# Autodesk Inventor assembly: Assembly1
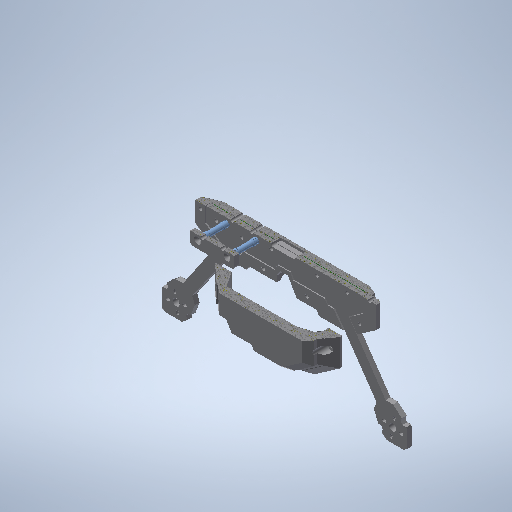
[picture p0: Inventor's stored thumbnail of the model, 512x512]
Saved by Autodesk Inventor 2025.2 (Build 292293000, 293)
## iProperties
Created: 2026-05-18
Part Number: Assembly1
Document SubType Name: Assembly
Designer: crazi
Author: crazi
## Documents named in this file (11)
- D:\Family\Arav\Projects\Drone\Chassis\Custom Chassis\Modelled\Assembly1.iam
- D:\Family\Arav\Projects\Drone\Chassis\Custom Chassis\Modelled\Base Model.ipt
- D:\Family\Arav\Projects\Drone\Chassis\Custom Chassis\Modelled\Top Cap.ipt
- D:\Family\Arav\Projects\Drone\Chassis\Custom Chassis\Modelled\Large Standoff.ipt
- D:\Family\Arav\Projects\Drone\Chassis\Custom Chassis\Modelled\FC Mount.ipt
- D:\Family\Arav\Projects\Drone\Chassis\Custom Chassis\Modelled\Bottom Cap.ipt
- D:\Family\Arav\Projects\Drone\Chassis\Custom Chassis\Modelled\Battery.ipt
- D:\Family\Arav\Projects\Drone\Chassis\Custom Chassis\Modelled\Bottom Cap V2.ipt
- D:\Family\Arav\Projects\Drone\Chassis\Custom Chassis\Modelled\Bottom Cap V3 - Main.ipt
- D:\Family\Arav\Projects\Drone\Chassis\Custom Chassis\Modelled\Bottom Cap V3 - Lower.ipt
- D:\Family\Arav\Projects\Drone\Chassis\Custom Chassis\Modelled\Shock Absorber.ipt
## Components (13 placed, 10 different names)
1. Base Model:1 — Mate:1, Mate:2, Mate:3, Mate:4, Mate:5, Mate:6, Mate:7, Mate:8, Mate:22, Mate:23, Mate:24
2. Top Cap:1 — Mate:1, Mate:2, Mate:3, Mate:17, Mate:18, Mate:19
3. Large Standoff:1 — Mate:4, Flush:3, Mate:8, Mate:9, Mate:11
4. Large Standoff:2 — Mate:5, Flush:2, Flush:3
5. Large Standoff:3 — Mate:6, Flush:1, Mate:10
6. Large Standoff:4 — Mate:7, Flush:1, Flush:2
7. FC Mount:1 — Mate:9, Mate:10, Mate:11
8. Bottom Cap:1 — Mate:14, Mate:15, Mate:16
9. Battery:1 — Mate:14, Mate:15, Mate:16
10. Bottom Cap V2:1
11. Bottom Cap V3 - Main:1 — Mate:17, Mate:18, Mate:19, Mate:20, Mate:21
12. Bottom Cap V3 - Lower:1 — Mate:20, Mate:21
13. Shock Absorber:1 — Mate:22, Mate:23, Mate:24
## Relationships (25: Mate 22, Flush 3)
- Mate:1 (0.5 mm): Base Model:1 ↔ Top Cap:1
- Mate:2 (0.5 mm): Base Model:1 ↔ Top Cap:1
- Mate:3 (0.5 mm): Base Model:1 ↔ Top Cap:1
- Mate:4: Base Model:1 ↔ Large Standoff:1
- Mate:5: Base Model:1 ↔ Large Standoff:2
- Mate:6: Base Model:1 ↔ Large Standoff:3
- Mate:7: Base Model:1 ↔ Large Standoff:4
- Flush:1: Large Standoff:3 ↔ Large Standoff:4
- Flush:2: Large Standoff:2 ↔ Large Standoff:4
- Flush:3: Large Standoff:1 ↔ Large Standoff:2
- Mate:8: Base Model:1 ↔ Large Standoff:1
- Mate:9: Large Standoff:1 ↔ FC Mount:1
- Mate:10: Large Standoff:3 ↔ FC Mount:1
- Mate:11: Large Standoff:1 ↔ FC Mount:1
- Mate:14 (10 mm): Bottom Cap:1 ↔ Battery:1
- Mate:15 (7 mm): Bottom Cap:1 ↔ Battery:1
- Mate:16 (7 mm): Bottom Cap:1 ↔ Battery:1
- Mate:17: Top Cap:1 ↔ Bottom Cap V3 - Main:1
- Mate:18: Top Cap:1 ↔ Bottom Cap V3 - Main:1
- Mate:19: Top Cap:1 ↔ Bottom Cap V3 - Main:1
- Mate:20: Bottom Cap V3 - Main:1 ↔ Bottom Cap V3 - Lower:1
- Mate:21: Bottom Cap V3 - Main:1 ↔ Bottom Cap V3 - Lower:1
- Mate:22: Base Model:1 ↔ Shock Absorber:1
- Mate:23: Base Model:1 ↔ Shock Absorber:1
- Mate:24: Base Model:1 ↔ Shock Absorber:1
